# Autodesk Inventor assembly: SE0001AN000_G01_109
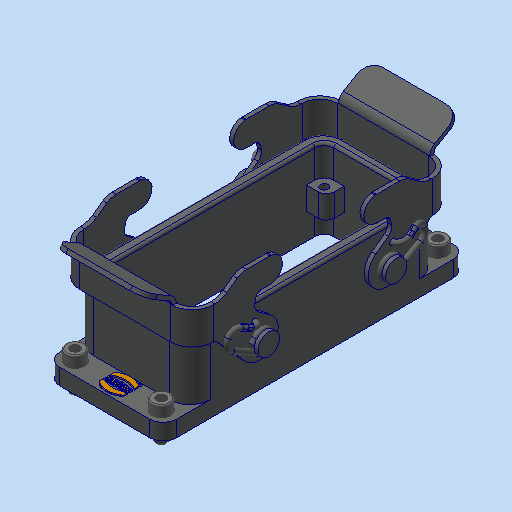
[picture p0: Inventor's stored thumbnail of the model, 512x512]
Saved by Autodesk Inventor 2023.3 (Build 273359000, 359)
## iProperties
Created: 2016-02-02
Part Number: SE0001AN000_G01_109
Document SubType Name: Assembly
Designer: pts9bw
Description: =<RBPARTNOTITLE2>
Vendor: --
Mass: 8.04402 g
Surface Area: 12.329 cm^2
Volume: 1.02472 cm^3
Density: 7.85 g/cm^3
AnP_Kommentar_aktuell: =<Comments>
AnP_Material_aktuell: =<Material>
RBMATERIAL: =<Material>
RBMATNO: =<Part Number>
RBPARTNOTITLE1: Base Plate with screws
RBPARTNOTITLE2: 16 B Anbaugehäuse mit Schrauben
AnP_Kategorie: 98
AnP_Material: =<Material>
RBDRAWINGMISSINGSPEC: --
Author: pts9bw
Keywords: =<RBPARTMADEOF>
Comments: =<RBSURFACE2>
Revision Number: 01
## Documents named in this file (3)
- C:\Users\rea9an\Documents\Inventor\TCAI2412_te1910_EM\AS00000980.iam
- C:\Users\rea9an\Documents\Inventor\TCAI2412_te1910_EM\PT00004793.ipt
- C:\Users\rea9an\Documents\Inventor\TCAI2412_te1910_EM\PT00004866.ipt
## Components (5 placed, 2 different names)
1. PT00004793:1 — Einfügen:1, Einfügen:2, Einfügen:3, Einfügen:4
2. PT00004866:1 — Einfügen:1
3. PT00004866:2 — Einfügen:2
4. PT00004866:3 — Einfügen:4
5. PT00004866:4 — Einfügen:3
## Relationships (4: Insert 4)
- Einfügen:1 [Insert]: PT00004793:1 ↔ PT00004866:1
- Einfügen:2 [Insert]: PT00004793:1 ↔ PT00004866:2
- Einfügen:3 [Insert]: PT00004793:1 ↔ PT00004866:4
- Einfügen:4 [Insert]: PT00004793:1 ↔ PT00004866:3
